# Autodesk Inventor assembly: 1_Cobot
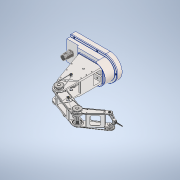
[picture p0: Inventor's stored thumbnail of the model, 180x180]
Saved by Autodesk Inventor 2021 (Build 250183000, 183)
## iProperties
Created: 2025-11-12
Part Number: 1_Cobot
Document SubType Name: Assembly
Designer: Admin
Mass: 54117.3 g
Surface Area: 31204 cm^2
Volume: 24625.3 cm^3
Density: 2.19763 g/cm^3
Author: Admin
## Documents named in this file (6)
- C:\Users\Admin\OneDrive - Politecnico di Milano\File di Erwin Rafael Novicio - Industrial Robotics SY 25-26\3D Model\COBOT - no shaftkeys\Manipulator_4DOFs.iam
- C:\Users\Admin\OneDrive - Politecnico di Milano\File di Erwin Rafael Novicio - Industrial Robotics SY 25-26\3D Model\COBOT - no shaftkeys\1.2_CobotArm.iam
- C:\Users\Admin\OneDrive - Politecnico di Milano\File di Erwin Rafael Novicio - Industrial Robotics SY 25-26\3D Model\COBOT - no shaftkeys\1.3_CobotArm.iam
- C:\Users\Admin\OneDrive - Politecnico di Milano\File di Erwin Rafael Novicio - Industrial Robotics SY 25-26\3D Model\COBOT - no shaftkeys\1.1_FixedArm.iam
- C:\Users\Admin\OneDrive - Politecnico di Milano\File di Erwin Rafael Novicio - Industrial Robotics SY 25-26\3D Model\COBOT - no shaftkeys\1.4_EndEffector.iam
- C:\Users\Admin\OneDrive - Politecnico di Milano\File di Erwin Rafael Novicio - Industrial Robotics SY 25-26\3D Model\COBOT - no shaftkeys\1.5_Base.iam
## Components (5 placed, 5 different names)
1. 1.2_CobotArm:1 [sub-assembly] — Mate:1, Mate:2, Flush:1, Mate:3
2. 1.3_CobotArm:1 [sub-assembly] — Mate:1, Mate:2, Flush:5, Mate:5
3. 1.1_FixedArm:1 [sub-assembly] — Flush:1, Mate:3, Mate:6, Mate:9, Flush:9
4. 1.4_EndEffector:1 [sub-assembly] — Flush:5, Mate:5
5. 1.5_Base:1 [sub-assembly] — Flush:6, Mate:9, Flush:7
## Relationships (11: Mate 6, Flush 5)
- Mate:1: 1.2_CobotArm:1 ↔ 1.3_CobotArm:1
- Mate:2: 1.2_CobotArm:1 ↔ 1.3_CobotArm:1
- Flush:1: 1.2_CobotArm:1 ↔ 1.1_FixedArm:1
- Mate:3: 1.2_CobotArm:1 ↔ 1.1_FixedArm:1
- Flush:5: 1.3_CobotArm:1 ↔ 1.4_EndEffector:1
- Mate:5: 1.3_CobotArm:1 ↔ 1.4_EndEffector:1
- Mate:6: 1.1_FixedArm:1
- Flush:6: 1.5_Base:1
- Mate:9: 1.1_FixedArm:1 ↔ 1.5_Base:1
- Flush:7: 1.5_Base:1
- Flush:9 (-500 mm): 1.1_FixedArm:1
